# Autodesk Inventor assembly: ensambleGeneral
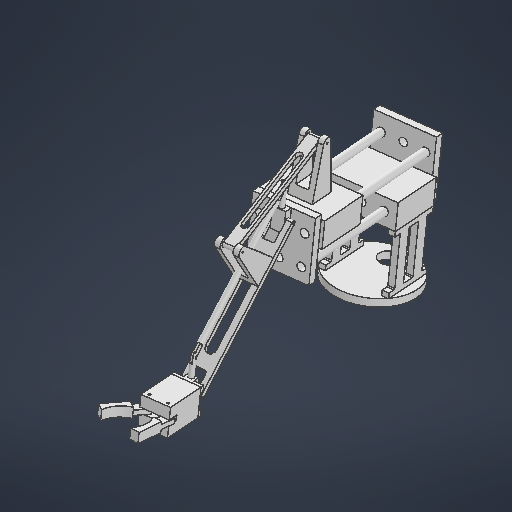
[picture p0: Inventor's stored thumbnail of the model, 512x512]
Saved by Autodesk Inventor 2027.1 (Build 311270010, 270A)
## iProperties
Created: 2026-11-07
Part Number: ensambleGeneral
Document SubType Name: Assembly
Designer: MANGEL
Author: MANGEL
## Documents named in this file (6)
- C:\Users\MANGEL\Desktop\Brazo 4GL\ensambleGeneral.iam
- C:\Users\MANGEL\Desktop\Brazo 4GL\ensamble6.iam
- C:\Users\MANGEL\Desktop\Brazo 4GL\ENSAMBLE3.iam
- C:\Users\MANGEL\Desktop\Brazo 4GL\ensamble5.iam
- C:\Users\MANGEL\Desktop\Brazo 4GL\soporteRodillo.ipt
- C:\Users\MANGEL\Desktop\Brazo 4GL\barillaBrazo.ipt
## Components (6 placed, 5 different names)
1. ensamble6:1 [sub-assembly] — Insertar:1, Coincidencia:1, Insertar:2, Nivelación:1, Insertar:4
2. ENSAMBLE3:1 [sub-assembly] — Insertar:1, Insertar:3
3. ensamble5:1 [sub-assembly] — Coincidencia:1, Insertar:2, Nivelación:1
4. soporteRodillo:2 — Insertar:3, Insertar:5
5. soporteRodillo:3 — Insertar:4, Coincidencia:2, Insertar:6
6. barillaBrazo:1 — Insertar:5, Coincidencia:2, Insertar:6
## Relationships (9: Insert 6, Mate 2, Flush 1)
- Insertar:1 (3.5 mm): ensamble6:1 ↔ ENSAMBLE3:1
- Coincidencia:1 [Mate]: ensamble6:1 ↔ ensamble5:1
- Insertar:2: ensamble6:1 ↔ ensamble5:1
- Nivelación:1 [Flush]: ensamble6:1 ↔ ensamble5:1
- Insertar:3: ENSAMBLE3:1 ↔ soporteRodillo:2
- Insertar:4: ensamble6:1 ↔ soporteRodillo:3
- Insertar:5: soporteRodillo:2 ↔ barillaBrazo:1
- Coincidencia:2 [Mate]: soporteRodillo:3 ↔ barillaBrazo:1
- Insertar:6: soporteRodillo:3 ↔ barillaBrazo:1
